# Autodesk Inventor assembly: ASY DMF-0010 Disk Micro Filter
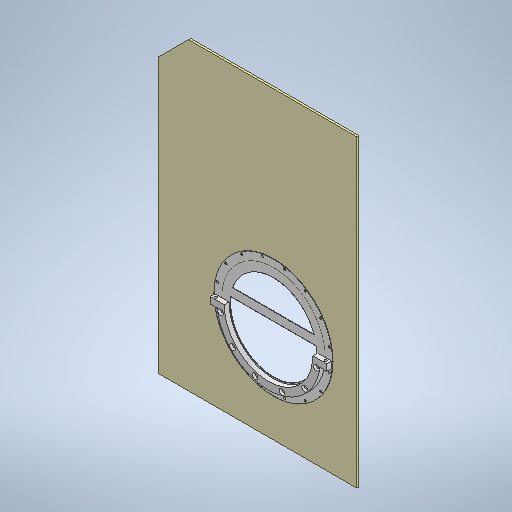
[picture p0: Inventor's stored thumbnail of the model, 512x512]
Saved by Autodesk Inventor 2026.2 (Build 302298000, 298)
## iProperties
Part Number: ASY DMF-0010 Disk Micro Filter
Document SubType Name: Assembly
Designer: admin
Stock Number: DMF-0010
Author: admin
## Documents named in this file (41)
- C:\Users\admin\Documents\Inventor\DMF-Disk-Micro-Filter\ASY DMF-0010 Disk Micro Filter.iam
- C:\Users\admin\Documents\Inventor\DMF-Disk-Micro-Filter\DMF-3004 Wall Right.ipt
- C:\Users\admin\Documents\Inventor\DMF-Disk-Micro-Filter\DMF-3001 Wall Bottom.ipt
- C:\Users\admin\Documents\Inventor\DMF-Disk-Micro-Filter\DMF-3002 Wall Face.ipt
- C:\Users\admin\Documents\Inventor\DMF-Disk-Micro-Filter\DMF-4004 Bed Stern 01.ipt
- C:\Users\admin\Documents\Inventor\DMF-Disk-Micro-Filter\DMF-2006 Tray Holder.ipt
- C:\Users\admin\Documents\Inventor\DMF-Disk-Micro-Filter\ASY DMF-2000 Sludge Tray.iam
- C:\Users\admin\Documents\Inventor\DMF-Disk-Micro-Filter\DMF-3008 Comb.ipt
- C:\Users\admin\Documents\Inventor\DMF-Disk-Micro-Filter\DMF-3007 Cover.ipt
- C:\Users\admin\Documents\Inventor\DMF-Disk-Micro-Filter\DMF-3009 Nozzle Pipe.ipt
- C:\Users\admin\Documents\Inventor\DMF-Disk-Micro-Filter\ASY DMF-3100 Face Wall Frame.iam
- C:\Users\admin\Documents\Inventor\DMF-Disk-Micro-Filter\DMF-5001 Корпусный подшипник Bearing Unit D35.ipt
- C:\Users\admin\Documents\Inventor\DMF-Disk-Micro-Filter\DMF-5002 Мотор-редуктор Gear Motor NMRV 090(80B5).ipt
- C:\Users\admin\Documents\Inventor\DMF-Disk-Micro-Filter\DMF-3011 Pancake.ipt
- C:\Users\admin\Documents\Inventor\DMF-Disk-Micro-Filter\DMF-4006 Bed Leg.ipt
- C:\Users\admin\Documents\Inventor\DMF-Disk-Micro-Filter\DMF-3006 Hat.ipt
- C:\Users\admin\Documents\Inventor\DMF-Disk-Micro-Filter\DMF-3005 Flange Exit.ipt
- C:\Users\admin\Documents\Inventor\DMF-Disk-Micro-Filter\Барабан v2.1\ASY DMF-1000 Drum.iam
- C:\Users\admin\Documents\Inventor\DMF-Disk-Micro-Filter\Барабан v2.1\DMF-4001 Small Gear.ipt
- C:\Users\admin\Documents\Inventor\DMF-Disk-Micro-Filter\DMF-1011 Support Ring Tail.ipt
- C:\Users\admin\Documents\Inventor\DMF-Disk-Micro-Filter\DMF-3010 Collector Blank.ipt
- C:\Users\admin\Documents\Inventor\DMF-Disk-Micro-Filter\Барабан v2.1\DMF-1207 Slot Plate Small.ipt
- C:\Users\admin\Documents\Inventor\DMF-Disk-Micro-Filter\Барабан v2.1\DMF-1205 Gear Ring 01.ipt
- C:\Users\admin\Documents\Inventor\DMF-Disk-Micro-Filter\DMF-1005 Side Stiffener 01.ipt
- C:\Users\admin\Documents\Inventor\DMF-Disk-Micro-Filter\DMF-1013 Side Stiffener 02.ipt
- C:\Users\admin\Documents\Inventor\DMF-Disk-Micro-Filter\DMF-3003 Wall Left.ipt
- C:\Users\admin\Documents\Inventor\DMF-Disk-Micro-Filter\Барабан v2.1\DMF-1009 Support Ring Bow.ipt
- C:\Users\admin\Documents\Inventor\DMF-Disk-Micro-Filter\ASY DMF-4100 Motor Stand.iam
- C:\Users\admin\Documents\Inventor\DMF-Disk-Micro-Filter\Барабан v2.1\DMF-1211 Gear Ring 02.ipt
- C:\Users\admin\Documents\Inventor\DMF-Disk-Micro-Filter\DMF-4008 Bed Stern 02.ipt
- C:\Users\admin\Documents\Inventor\DMF-Disk-Micro-Filter\ASY DMF-4200 Drive Shaft.iam
- C:\Users\admin\Documents\Inventor\DMF-Disk-Micro-Filter\ASY DMF-6100 Dummy Frame.iam
- C:\Users\admin\Documents\Inventor\DMF-Disk-Micro-Filter\DMF-3012 Front Wall Dummy.ipt
- C:\Users\admin\Documents\Inventor\DMF-Disk-Micro-Filter\ASY DMF-1600 Front Connector.iam
- C:\Users\admin\Documents\Inventor\DMF-Disk-Micro-Filter\DMF-4203 Stud 03.ipt
- C:\Users\admin\Documents\Inventor\DMF-Disk-Micro-Filter\DMF-4201 Stud 01.ipt
- C:\Users\admin\Documents\Inventor\DMF-Disk-Micro-Filter\DMF-3013 Back Wall Dummy.ipt
- C:\Users\admin\Documents\Inventor\DMF-Disk-Micro-Filter\DMF-4103 Gearbox Stand 02.ipt
- C:\Users\admin\Documents\Inventor\DMF-Disk-Micro-Filter\DMF-4105 Plate Holes Center.ipt
- C:\Users\admin\Documents\Inventor\DMF-Disk-Micro-Filter\DMF-4106 Plate 2 Holes.ipt
- C:\Users\admin\Documents\Inventor\DMF-Disk-Micro-Filter\DMF-4104 Plate Holes Edge.ipt
## Components (54 placed, 40 different names)
1. ASY DMF-1000 Drum:1 [sub-assembly] — Rotation:1, Flush:16
2. ASY DMF-2000 Sludge Tray:1 [sub-assembly] — Rigid:24
3. ASY DMF-3100 Face Wall Frame:1 [sub-assembly] — Flush:11, Mate:21, Flush:12, Flush:17
4. DMF-3004 Wall Right:1 — Rigid:8, Mate:14, Rigid:12
5. DMF-1011 Support Ring Tail:1
6. DMF-3003 Wall Left:1 — Rigid:15, Rigid:16, Mate:21, Flush:12
7. DMF-3001 Wall Bottom:1 — Mate:10, Flush:20, Rigid:8, Mate:12, Rigid:16, Flush:11
8. DMF-3002 Wall Face:1 — Rigid:15
9. DMF-1205 Gear Ring 01:1 — Rigid:11, Rotational:6, Rigid:22
10. DMF-4004 Bed Stern 01:1 — Rigid:11, Rotational:5, Rotational:7
11. DMF-2006 Tray Holder:1
12. DMF-3008 Comb:1
13. DMF-3007 Cover:1 — Mate:14, Mate:20, Flush:10
14. DMF-3009 Nozzle Pipe:1
15. DMF-5002 Мотор-редуктор Gear Motor NMRV 090(80B5):1 — Rotational:3
16. DMF-3011 Pancake:1
17. DMF-4006 Bed Leg:1 — Mate:34
18. DMF-3006 Hat:1
19. DMF-3005 Flange Exit:1
20. DMF-4001 Small Gear:1 — Rigid:17, Rotation:1, Flush:16
21. DMF-3010 Collector Blank:1 — Mate:20, Flush:10
22. DMF-3009 Nozzle Pipe:2
23. DMF-1207 Slot Plate Small:1
24. DMF-1005 Side Stiffener 01:1
25. DMF-1013 Side Stiffener 02:1
26. DMF-1009 Support Ring Bow:1 — Rotational:7
27. DMF-4104 Plate Holes Edge:1
28. DMF-4106 Plate 2 Holes:1
29. DMF-4105 Plate Holes Center:1
30. DMF-4103 Gearbox Stand 02:1
31. ASY DMF-4100 Motor Stand:1 [sub-assembly] — Mate:33, Mate:34, Cylindrical:3, Cylindrical:4
32. DMF-1211 Gear Ring 02:1 — Rigid:12, Rigid:13
33. DMF-4008 Bed Stern 02:1 — Rigid:13
34. DMF-5001 Корпусный подшипник Bearing Unit D35:1 — Flush:13, Flush:17
35. DMF-5001 Корпусный подшипник Bearing Unit D35:2 — Flush:13
36. ASY DMF-4200 Drive Shaft:1 [sub-assembly] — Rigid:17, Rotational:3
37. ASY DMF-6100 Dummy Frame:1 [sub-assembly] — Mate:37, Flush:29, Flush:30, Mate:38, Flush:31, Flush:32
38. DMF-3012 Front Wall Dummy:1 — Rigid:22, Mate:30, Mate:37, Flush:29, Flush:30
39. DMF-5002 Мотор-редуктор Gear Motor NMRV 090(80B5):2
40. ASY DMF-1000 Drum:2 [sub-assembly] — Rotational:5
41. DMF-4001 Small Gear:2
42. ASY DMF-4200 Drive Shaft:2 [sub-assembly] — Mate:30, Mate:31, Mate:32
43. ASY DMF-1600 Front Connector:1 [sub-assembly] — Rotational:6, Rigid:24
44. DMF-4203 Stud 03:1
45. DMF-4201 Stud 01:1
46. DMF-3013 Back Wall Dummy:1 — Rigid:25, Mate:38, Flush:31, Flush:32
47. DMF-3003 Wall Left:2
48. DMF-3012 Front Wall Dummy:2
49. DMF-3013 Back Wall Dummy:2
50. DMF-3004 Wall Right:2
51. DMF-1211 Gear Ring 02:2 — Rigid:25, Rigid:26
52. DMF-4008 Bed Stern 02:2 — Rigid:26
53. DMF-5001 Корпусный подшипник Bearing Unit D35:3 — Mate:31, Mate:33, Cylindrical:3
54. DMF-5001 Корпусный подшипник Bearing Unit D35:4 — Mate:32, Cylindrical:4
## Relationships (56: WeldJoint 16, Mate 14, Flush 14, RevoluteJoint 6, CylindricalJoint 4, RelateRotation 2)
- [WeldJoint]: DMF-3011 Pancake:1 ↔ DMF-3006 Hat:1
- [WeldJoint]: DMF-3004 Wall Right:1 ↔ DMF-1011 Support Ring Tail:1
- [RevoluteJoint]: ASY DMF-1000 Drum:1 ↔ DMF-1011 Support Ring Tail:1
- [WeldJoint]: DMF-3009 Nozzle Pipe:1 ↔ DMF-3010 Collector Blank:1
- [WeldJoint]: DMF-3010 Collector Blank:1 ↔ DMF-3009 Nozzle Pipe:2
- [Mate]: DMF-3010 Collector Blank:1 ↔ DMF-1005 Side Stiffener 01:1
- [Mate]: DMF-3010 Collector Blank:1 ↔ DMF-1005 Side Stiffener 01:1
- [Flush]: DMF-2006 Tray Holder:1 ↔ DMF-1013 Side Stiffener 02:1
- Rigid:17 [WeldJoint]: DMF-4001 Small Gear:1 ↔ ASY DMF-4200 Drive Shaft:1
- Mate:10: DMF-3001 Wall Bottom:1
- Flush:20: DMF-3001 Wall Bottom:1
- Rigid:8 [WeldJoint] (-25 mm): DMF-3004 Wall Right:1 ↔ DMF-3001 Wall Bottom:1
- Mate:12 (3000 mm): DMF-3001 Wall Bottom:1
- Mate:14: DMF-3004 Wall Right:1 ↔ DMF-3007 Cover:1
- Rigid:11 [WeldJoint]: DMF-1205 Gear Ring 01:1 ↔ DMF-4004 Bed Stern 01:1
- Rigid:12 [WeldJoint]: DMF-3004 Wall Right:1 ↔ DMF-1211 Gear Ring 02:1
- Rigid:13 [WeldJoint]: DMF-1211 Gear Ring 02:1 ↔ DMF-4008 Bed Stern 02:1
- Mate:20: DMF-3007 Cover:1 ↔ DMF-3010 Collector Blank:1
- Flush:10: DMF-3007 Cover:1 ↔ DMF-3010 Collector Blank:1
- Rigid:15 [WeldJoint]: DMF-3003 Wall Left:1 ↔ DMF-3002 Wall Face:1
- Rigid:16 [WeldJoint]: DMF-3003 Wall Left:1 ↔ DMF-3001 Wall Bottom:1
- Flush:11: ASY DMF-3100 Face Wall Frame:1 ↔ DMF-3001 Wall Bottom:1
- Mate:21: ASY DMF-3100 Face Wall Frame:1 ↔ DMF-3003 Wall Left:1
- Flush:12: ASY DMF-3100 Face Wall Frame:1 ↔ DMF-3003 Wall Left:1
- [CylindricalJoint]: DMF-5001 Корпусный подшипник Bearing Unit D35:1 ↔ ASY DMF-4200 Drive Shaft:1
- [CylindricalJoint]: DMF-5001 Корпусный подшипник Bearing Unit D35:2 ↔ ASY DMF-4200 Drive Shaft:1
- Flush:13: DMF-5001 Корпусный подшипник Bearing Unit D35:1 ↔ DMF-5001 Корпусный подшипник Bearing Unit D35:2
- Rotation:1 [RelateRotation] (6 ul): ASY DMF-1000 Drum:1 ↔ DMF-4001 Small Gear:1
- Flush:16 (5 mm): ASY DMF-1000 Drum:1 ↔ DMF-4001 Small Gear:1
- Flush:17 (-140 mm): ASY DMF-3100 Face Wall Frame:1 ↔ DMF-5001 Корпусный подшипник Bearing Unit D35:1
- Rotational:3 [RevoluteJoint]: DMF-5002 Мотор-редуктор Gear Motor NMRV 090(80B5):1 ↔ ASY DMF-4200 Drive Shaft:1
- [WeldJoint]: DMF-4001 Small Gear:2 ↔ ASY DMF-4200 Drive Shaft:2
- [RelateRotation] (6 ul): ASY DMF-1000 Drum:2 ↔ DMF-4001 Small Gear:2
- [Flush] (5 mm): ASY DMF-1000 Drum:2 ↔ DMF-4001 Small Gear:2
- [RevoluteJoint]: DMF-5002 Мотор-редуктор Gear Motor NMRV 090(80B5):2 ↔ ASY DMF-4200 Drive Shaft:2
- Rotational:5 [RevoluteJoint]: DMF-4004 Bed Stern 01:1 ↔ ASY DMF-1000 Drum:2
- Rotational:6 [RevoluteJoint]: DMF-1205 Gear Ring 01:1 ↔ ASY DMF-1600 Front Connector:1
- Rotational:7 [RevoluteJoint]: DMF-4004 Bed Stern 01:1 ↔ DMF-1009 Support Ring Bow:1
- Rigid:22 [WeldJoint]: DMF-1205 Gear Ring 01:1 ↔ DMF-3012 Front Wall Dummy:1
- Rigid:25 [WeldJoint]: DMF-3013 Back Wall Dummy:1 ↔ DMF-1211 Gear Ring 02:2
- Mate:30: DMF-3012 Front Wall Dummy:1 ↔ ASY DMF-4200 Drive Shaft:2
- [Flush]: DMF-5001 Корпусный подшипник Bearing Unit D35:3 ↔ DMF-5001 Корпусный подшипник Bearing Unit D35:4
- Mate:31: ASY DMF-4200 Drive Shaft:2 ↔ DMF-5001 Корпусный подшипник Bearing Unit D35:3
- Mate:32: ASY DMF-4200 Drive Shaft:2 ↔ DMF-5001 Корпусный подшипник Bearing Unit D35:4
- Mate:33: ASY DMF-4100 Motor Stand:1 ↔ DMF-5001 Корпусный подшипник Bearing Unit D35:3
- Mate:34: DMF-4006 Bed Leg:1 ↔ ASY DMF-4100 Motor Stand:1
- Cylindrical:3: ASY DMF-4100 Motor Stand:1 ↔ DMF-5001 Корпусный подшипник Bearing Unit D35:3
- Cylindrical:4: ASY DMF-4100 Motor Stand:1 ↔ DMF-5001 Корпусный подшипник Bearing Unit D35:4
- Rigid:24 [WeldJoint]: ASY DMF-2000 Sludge Tray:1 ↔ ASY DMF-1600 Front Connector:1
- Mate:37: ASY DMF-6100 Dummy Frame:1 ↔ DMF-3012 Front Wall Dummy:1
- Flush:29: ASY DMF-6100 Dummy Frame:1 ↔ DMF-3012 Front Wall Dummy:1
- Flush:30: ASY DMF-6100 Dummy Frame:1 ↔ DMF-3012 Front Wall Dummy:1
- Mate:38: ASY DMF-6100 Dummy Frame:1 ↔ DMF-3013 Back Wall Dummy:1
- Flush:31: ASY DMF-6100 Dummy Frame:1 ↔ DMF-3013 Back Wall Dummy:1
- Flush:32: ASY DMF-6100 Dummy Frame:1 ↔ DMF-3013 Back Wall Dummy:1
- Rigid:26 [WeldJoint]: DMF-1211 Gear Ring 02:2 ↔ DMF-4008 Bed Stern 02:2
## Named parameters: d115_d100 = 6, d116_d102 = 5 mm, d117_d108 = 0 mm, d118_d109 = -100.113633 deg, d119_d277 = 0 mm, d120_d278 = -13.649853 deg, d146_d89 = 0 mm
